# Autodesk Inventor assembly: sliding_mechanism
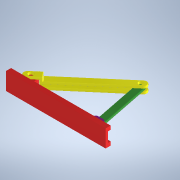
[picture p0: Inventor's stored thumbnail of the model, 180x180]
Saved by Autodesk Inventor 2022 (Build 260153000, 153)
## iProperties
Created: 2024-11-08
Part Number: sliding_mechanism
Document SubType Name: Assembly
Designer: Dell
Author: Dell
## Documents named in this file (5)
- C:\Users\Dell\Desktop\CAD MY EX Ah\sliding_mechanism.iam
- C:\Users\Dell\Desktop\CAD MY EX Ah\base.ipt
- C:\Users\Dell\Desktop\CAD MY EX Ah\arm_link.ipt
- C:\Users\Dell\Desktop\CAD MY EX Ah\connecting_link.ipt
- C:\Users\Dell\Desktop\CAD MY EX Ah\sliding_link.ipt
## Components (5 placed, 4 different names)
1. base:1 — Mate:1, Mate:2, Mate:3, Mate:4, Mate:5, Mate:6, Mate:7
2. arm_link:1 — Mate:3, Mate:4, Mate:7, Mate:8, Mate:9
3. arm_link:2 — Mate:5, Mate:6, Mate:9, Mate:10
4. connecting_link:1 — Mate:8, Mate:10, Mate:11
5. sliding_link:1 — Mate:1, Mate:2, Mate:11
## Relationships (11: Mate 11)
- Mate:1: base:1 ↔ sliding_link:1
- Mate:2: base:1 ↔ sliding_link:1
- Mate:3: base:1 ↔ arm_link:1
- Mate:4: base:1 ↔ arm_link:1
- Mate:5: base:1 ↔ arm_link:2
- Mate:6: base:1 ↔ arm_link:2
- Mate:7: base:1 ↔ arm_link:1
- Mate:8: arm_link:1 ↔ connecting_link:1
- Mate:9: arm_link:1 ↔ arm_link:2
- Mate:10: arm_link:2 ↔ connecting_link:1
- Mate:11: connecting_link:1 ↔ sliding_link:1
